# Autodesk Inventor assembly: robotfish_new_1
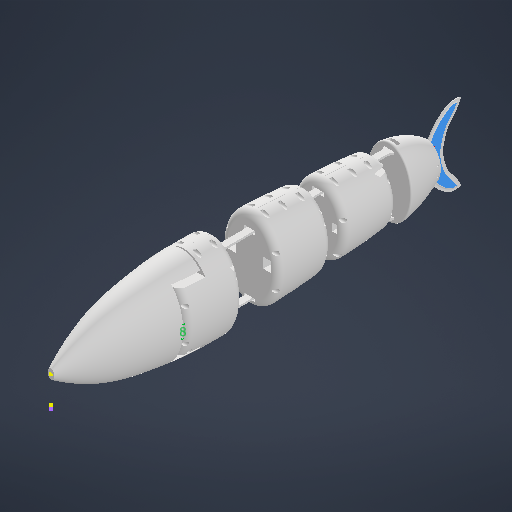
[picture p0: Inventor's stored thumbnail of the model, 512x512]
Saved by Autodesk Inventor 2027 (Build 310192060, 192F)
## iProperties
Created: 2026-08-24
Part Number: robotfish_new_1
Document SubType Name: Assembly
Designer: thita
Sending System: Autodesk Inventor 2027
Preprocessor: ST-DEVELOPER v20.1
Title: robotfish_newest_1.stp
Author: thita
## Documents named in this file (21)
- C:\Users\thita\ROBOT CÁ\robotfish_newest\robotfish_newest_1\robotfish_newest_1.iam
- C:\Users\thita\ROBOT CÁ\robotfish_newest\robotfish_newest_1\thanh lk.ipt
- C:\Users\thita\ROBOT CÁ\robotfish_newest\robotfish_newest_1\thanh lk 1.ipt
- C:\Users\thita\ROBOT CÁ\robotfish_newest\robotfish_newest_1\manh_tren_truc_2.ipt
- C:\Users\thita\ROBOT CÁ\robotfish_newest\robotfish_newest_1\manh_tren_truc_3.ipt
- C:\Users\thita\ROBOT CÁ\robotfish_newest\robotfish_newest_1\head.ipt
- C:\Users\thita\ROBOT CÁ\robotfish_newest\robotfish_newest_1\truc_khop_3_MIR.ipt
- C:\Users\thita\ROBOT CÁ\robotfish_newest\robotfish_newest_1\hop v3.iam
- C:\Users\thita\ROBOT CÁ\robotfish_newest\robotfish_newest_1\Assembly1.iam
- C:\Users\thita\ROBOT CÁ\robotfish_newest\robotfish_newest_1\thanh lk 2.ipt
- C:\Users\thita\ROBOT CÁ\robotfish_newest\robotfish_newest_1\thanh lk 4.ipt
- C:\Users\thita\ROBOT CÁ\robotfish_newest\robotfish_newest_1\thanhlk 3.ipt
- C:\Users\thita\ROBOT CÁ\robotfish_newest\robotfish_newest_1\segment2.ipt
- C:\Users\thita\ROBOT CÁ\robotfish_newest\robotfish_newest_1\thanhlk 5.ipt
- C:\Users\thita\ROBOT CÁ\robotfish_newest\robotfish_newest_1\vây đuôi phương án A.ipt
- C:\Users\thita\ROBOT CÁ\robotfish_newest\robotfish_newest_1\rigid_tailtail.ipt
- C:\Users\thita\ROBOT CÁ\robotfish_newest\robotfish_newest_1\segment3.ipt
- C:\Users\thita\ROBOT CÁ\robotfish_newest\segment1.ipt
- C:\Users\thita\ROBOT CÁ\robotfish_newest\robotfish_newest\segment1_left.ipt
- C:\Users\thita\ROBOT CÁ\robotfish_newest\robotfish_newest\segment2_left.ipt
- C:\Users\thita\ROBOT CÁ\robotfish_newest\robotfish_newest_1\segment3_left.ipt
## Components (21 placed, 20 different names)
1. thanh lk:1
2. thanh lk 1:1
3. manh_tren_truc_2:1
4. manh_tren_truc_3:1
5. head:1
6. truc_khop_3_MIR:1
7. hop v3:13 [sub-assembly] — Rigid:5
8. hop v3:14 [sub-assembly] — Rigid:4
9. Assembly1:17 [sub-assembly] — Rigid:1
10. thanh lk 2:1
11. thanh lk 4:2
12. thanhlk 3:2
13. segment2:1
14. thanhlk 5:2
15. vây đuôi phương án A:2
16. rigid_tailtail:3
17. segment3:2
18. segment1:2 — Rigid:1, Rigid:2
19. segment1_left:1 — Rigid:2
20. segment2_left:1 — Rigid:5
21. segment3_left:1 — Rigid:4
## Relationships (4: WeldJoint 4)
- Rigid:1 [WeldJoint]: Assembly1:17 ↔ segment1:2
- Rigid:2 [WeldJoint]: segment1:2 ↔ segment1_left:1
- Rigid:4 [WeldJoint]: hop v3:14 ↔ segment3_left:1
- Rigid:5 [WeldJoint]: hop v3:13 ↔ segment2_left:1
